# Autodesk Inventor assembly: Tabletop Laptop Riser (Finial Project)
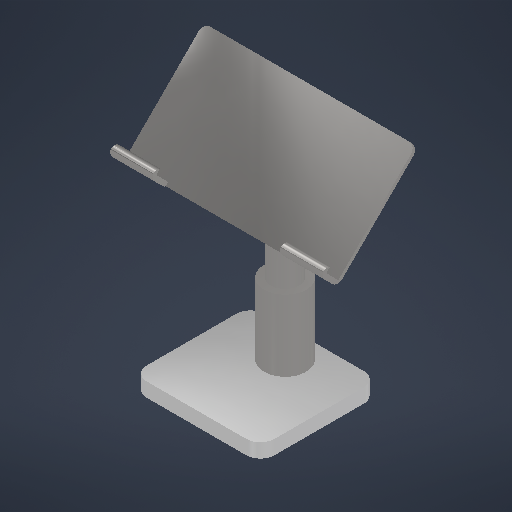
[picture p0: Inventor's stored thumbnail of the model, 512x512]
Saved by Autodesk Inventor 2026.1 (Build 301233020, 233B)
## iProperties
Created: 2025-12-01
Part Number: Tabletop Laptop Riser (Finial Project)
Document SubType Name: Assembly
Designer: gmz
Author: gmz
## Documents named in this file (5)
- C:\Users\geoza\Downloads\Tabletop Laptop Riser (Finial Project).iam
- C:\Users\geoza\OneDrive\Documents\Inventor\Content Center Files\R2026\en-US\ANSI B18.2.1(3)\ANSI B18.2.1 - 3_8-24 UNF - 1.25(3).ipt
- C:\Users\geoza\Downloads\Base plate (Final Project).ipt
- C:\Users\geoza\Downloads\Connecting Rod (Final Project).ipt
- C:\Users\geoza\Downloads\Holder (Final Project).ipt
## Components (4 placed, 4 different names)
1. Base plate (Final Project):1 — Rotational:1, Rotational:2
2. Connecting Rod (Final Project):1 — Rotational:1, Rigid:2
3. Holder (Final Project):1 — Rigid:2
4. Hex Cap Screw - Inch 3/8-24 UNF - 1.25:2 — Rotational:2
## Relationships (3: RevoluteJoint 2, WeldJoint 1)
- Rotational:1 [RevoluteJoint]: Base plate (Final Project):1 ↔ Connecting Rod (Final Project):1
- Rigid:2 [WeldJoint]: Connecting Rod (Final Project):1 ↔ Holder (Final Project):1
- Rotational:2 [RevoluteJoint] (31.75 mm): Base plate (Final Project):1 ↔ Hex Cap Screw - Inch 3/8-24 UNF - 1.25:2
